# Autodesk Inventor assembly: BG001_bensen22_26
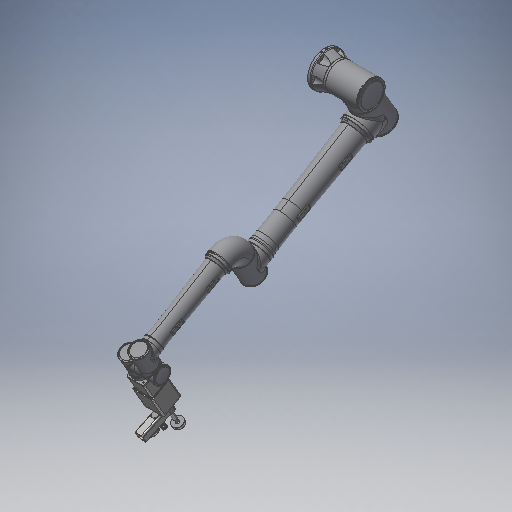
[picture p0: Inventor's stored thumbnail of the model, 512x512]
Saved by Autodesk Inventor 2025.3 (Build 293356000, 356)
## iProperties
Company: HTBLA Kaindorf
RuleStatus: InUse
Created: 2026-08-06
Part Number: BG001_bensen22_26
Project: Biegeroboter
Material: Generisch
Description: biegekopf_gesamt_v1
Document SubType Name: Assembly
Designer: bensen22
Mass: 57469.4 g
Surface Area: 29603.1 cm^2
Volume: 50293.9 cm^3
Density: 1.14267 g/cm^3
AfterDocNew0: iProperties-Editor_aufrufen
Author: sebas
Keywords: 2026
## Documents named in this file (8)
- C:\Users\trist\Desktop\Schule\diplomarbeit_dateien\Mechanik\Biegekopf\BG001_bensen22_26_Biegeroboter_biegekopf_gesamt_v1.iam
- C:\Users\trist\Desktop\Schule\diplomarbeit_dateien\Mechanik\Biegekopf\MATSUSHITA_MSMF082L1U1\AIS2024\MSMF082L1U1.iam
- C:\Users\trist\Desktop\Schule\diplomarbeit_dateien\Mechanik\Biegekopf\188635080-9-gearbox_ab115-100-s2-p2-12\gearbox_ab115-100-s2-p2-12.ipt
- C:\Users\trist\Desktop\Schule\diplomarbeit_dateien\Mechanik\Fairino FR20\Fairino FR20.iam
- C:\Users\trist\Desktop\Schule\diplomarbeit_dateien\Mechanik\Biegekopf\Gehäuse\BT002_bensen22_26_Biegeroboter_gehäuse_motor_v1.ipt
- C:\Users\trist\Desktop\Schule\diplomarbeit_dateien\Mechanik\Biegekopf\Gehäuse\BT001_bensen22_26_Biegeroboter_gehäuse_getriebe_v1.ipt
- C:\Users\trist\Desktop\Schule\diplomarbeit_dateien\Mechanik\Biegekopf\Gehäuse\BT006_bensen22_26_Biegeroboter_gehäuse_motor_deckel_v2.ipt
- C:\Users\trist\Desktop\Schule\diplomarbeit_dateien\Mechanik\Biegekopf\Verlängerung\BG002_bensen22_26_Biegeroboter_verlängerung_gesamt_v1.iam
## Components (7 placed, 7 different names)
1. MSMF082L1U1:1 [sub-assembly] — Passend:1, Passend:2, Passend:3, Passend:4, Passend:8
2. gearbox_ab115-100-s2-p2-12:1 — Passend:1, Passend:2, Passend:10, Passend:11, Passend:12, Passend:19, Passend:20, Passend:21
3. Fairino FR20:1 [sub-assembly] — Passend:25, Passend:26, Passend:27
4. BT002_bensen22_26_Biegeroboter_gehäuse_motor_v1:1 — Passend:3, Passend:4, Passend:8, Fluchtend:3, Passend:22, Passend:23, Passend:24
5. BT001_bensen22_26_Biegeroboter_gehäuse_getriebe_v1:1 — Passend:10, Passend:11, Passend:12, Fluchtend:3
6. BT006_bensen22_26_Biegeroboter_gehäuse_motor_deckel_v2:1 — Passend:22, Passend:23, Passend:24, Passend:25, Passend:26, Passend:27
7. BG002_bensen22_26_Biegeroboter_verlängerung_gesamt_v1:1 [sub-assembly] — Passend:19, Passend:20, Passend:21
## Relationships (18: Mate 17, Flush 1)
- Passend:1 [Mate]: MSMF082L1U1:1 ↔ gearbox_ab115-100-s2-p2-12:1
- Passend:2 [Mate]: MSMF082L1U1:1 ↔ gearbox_ab115-100-s2-p2-12:1
- Passend:3 [Mate]: MSMF082L1U1:1 ↔ BT002_bensen22_26_Biegeroboter_gehäuse_motor_v1:1
- Passend:4 [Mate] (15 mm): MSMF082L1U1:1 ↔ BT002_bensen22_26_Biegeroboter_gehäuse_motor_v1:1
- Passend:8 [Mate] (15 mm): MSMF082L1U1:1 ↔ BT002_bensen22_26_Biegeroboter_gehäuse_motor_v1:1
- Passend:10 [Mate] (7.5 mm): gearbox_ab115-100-s2-p2-12:1 ↔ BT001_bensen22_26_Biegeroboter_gehäuse_getriebe_v1:1
- Passend:11 [Mate] (7.5 mm): gearbox_ab115-100-s2-p2-12:1 ↔ BT001_bensen22_26_Biegeroboter_gehäuse_getriebe_v1:1
- Passend:12 [Mate]: gearbox_ab115-100-s2-p2-12:1 ↔ BT001_bensen22_26_Biegeroboter_gehäuse_getriebe_v1:1
- Fluchtend:3 [Flush] (-10 mm): BT002_bensen22_26_Biegeroboter_gehäuse_motor_v1:1 ↔ BT001_bensen22_26_Biegeroboter_gehäuse_getriebe_v1:1
- Passend:19 [Mate]: gearbox_ab115-100-s2-p2-12:1 ↔ BG002_bensen22_26_Biegeroboter_verlängerung_gesamt_v1:1
- Passend:20 [Mate]: gearbox_ab115-100-s2-p2-12:1 ↔ BG002_bensen22_26_Biegeroboter_verlängerung_gesamt_v1:1
- Passend:21 [Mate]: gearbox_ab115-100-s2-p2-12:1 ↔ BG002_bensen22_26_Biegeroboter_verlängerung_gesamt_v1:1
- Passend:22 [Mate]: BT002_bensen22_26_Biegeroboter_gehäuse_motor_v1:1 ↔ BT006_bensen22_26_Biegeroboter_gehäuse_motor_deckel_v2:1
- Passend:23 [Mate]: BT002_bensen22_26_Biegeroboter_gehäuse_motor_v1:1 ↔ BT006_bensen22_26_Biegeroboter_gehäuse_motor_deckel_v2:1
- Passend:24 [Mate]: BT002_bensen22_26_Biegeroboter_gehäuse_motor_v1:1 ↔ BT006_bensen22_26_Biegeroboter_gehäuse_motor_deckel_v2:1
- Passend:25 [Mate]: Fairino FR20:1 ↔ BT006_bensen22_26_Biegeroboter_gehäuse_motor_deckel_v2:1
- Passend:26 [Mate]: Fairino FR20:1 ↔ BT006_bensen22_26_Biegeroboter_gehäuse_motor_deckel_v2:1
- Passend:27 [Mate]: Fairino FR20:1 ↔ BT006_bensen22_26_Biegeroboter_gehäuse_motor_deckel_v2:1
